# Autodesk Inventor assembly: Mockup
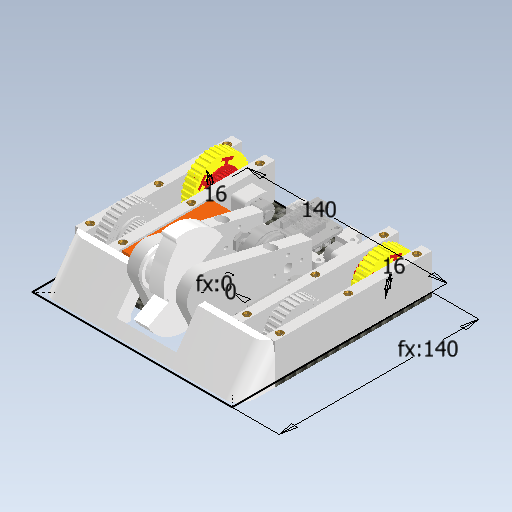
[picture p0: Inventor's stored thumbnail of the model, 512x512]
Saved by Autodesk Inventor 2026.4 (Build 304435030, 435C)
## iProperties
Created: 2026-11-08
Part Number: Mockup
Document SubType Name: Assembly
Designer: weira
Mass: 573.59 g
Surface Area: 731.437 cm^2
Volume: 125.835 cm^3
Density: 4.55828 g/cm^3
Author: weira
## Documents named in this file (10)
- C:\Users\weira\OneDrive\Desktop\Battlebot Projekt\Battle-Bot-Project\Inventor\Mockup.iam
- C:\Users\weira\OneDrive\Desktop\Battlebot Projekt\Battle-Bot-Project\Inventor\Kaufteile\MT2204_Brushless_Motor\MT2204_Brushless_Motor.ipt
- C:\Users\weira\OneDrive\Desktop\Battlebot Projekt\Battle-Bot-Project\Inventor\Fahrseite\Antrieb_links.iam
- C:\Users\weira\OneDrive\Desktop\Battlebot Projekt\Battle-Bot-Project\Inventor\Kaufteile\Tattu 2S 550mAh.ipt
- C:\Users\weira\OneDrive\Desktop\Battlebot Projekt\Battle-Bot-Project\Inventor\Kaufteile\Cyber_Brick_Receiver\Cyber_Brick_Receiver.ipt
- C:\Users\weira\OneDrive\Desktop\Battlebot Projekt\Battle-Bot-Project\Inventor\Kaufteile\Hobbywing_10A_ESC\Hobbywing_10A_ESC.ipt
- C:\Users\weira\OneDrive\Desktop\Battlebot Projekt\Battle-Bot-Project\Inventor\Bodenplatte.ipt
- C:\Users\weira\OneDrive\Desktop\Battlebot Projekt\Battle-Bot-Project\Inventor\Weaponassembly\Waffenhalterung_links.ipt
- C:\Users\weira\OneDrive\Desktop\Battlebot Projekt\Battle-Bot-Project\Inventor\Frontschild.ipt
- C:\Users\weira\OneDrive\Desktop\Battlebot Projekt\Battle-Bot-Project\Inventor\3D-Druckdaten\Waffendesign_infilloprimierer.ipt
## Components (11 placed, 9 different names)
1. Antrieb_links:1 [sub-assembly] — Passend:1, Fluchtend:1, Passend:2, Fluchtend:2, Passend:3, Fluchtend:5
2. Antrieb_links:2 [sub-assembly] — Fluchtend:2, Passend:3, Passend:4, Passend:5, Fluchtend:3, Fluchtend:4, Passend:13, Passend:24, Fluchtend:9
3. Bodenplatte:1 — Passend:5, Fluchtend:3, Fluchtend:4, Passend:12, Fluchtend:8
4. Tattu 2S 550mAh:1
5. Hobbywing_10A_ESC:1
6. Cyber_Brick_Receiver:1 — Passend:22, Passend:23, Fluchtend:7
7. Waffenhalterung_links:1 — Passend:7, Passend:9, Fluchtend:6, Passend:13, Passend:15, Passend:16, Passend:17, Passend:20, Passend:23
8. Waffenhalterung_links:2 — Passend:7, Passend:9, Passend:12, Fluchtend:6, Passend:22, Fluchtend:7, Passend:25, Passend:26, Passend:27
9. MT2204_Brushless_Motor:1 — Passend:15, Passend:16, Passend:17, Passend:20
10. Frontschild:1 — Fluchtend:8, Passend:24, Fluchtend:9, Passend:27
11. Waffendesign_infilloprimierer:1 — Passend:25, Passend:26
## Relationships (28: Mate 19, Flush 9)
- Passend:1 [Mate] (-70 mm): Antrieb_links:1
- Fluchtend:1 [Flush] (70 mm): Antrieb_links:1
- Passend:2 [Mate]: Antrieb_links:1
- Fluchtend:2 [Flush]: Antrieb_links:1 ↔ Antrieb_links:2
- Passend:3 [Mate] (-140 mm): Antrieb_links:1 ↔ Antrieb_links:2
- Passend:4 [Mate]: Antrieb_links:2
- Passend:5 [Mate]: Antrieb_links:2 ↔ Bodenplatte:1
- Fluchtend:3 [Flush]: Antrieb_links:2 ↔ Bodenplatte:1
- Fluchtend:4 [Flush]: Antrieb_links:2 ↔ Bodenplatte:1
- Fluchtend:5 [Flush]: Antrieb_links:1
- Passend:7 [Mate]: Waffenhalterung_links:1 ↔ Waffenhalterung_links:2
- Passend:9 [Mate] (26 mm): Waffenhalterung_links:1 ↔ Waffenhalterung_links:2
- Passend:12 [Mate]: Bodenplatte:1 ↔ Waffenhalterung_links:2
- Fluchtend:6 [Flush]: Waffenhalterung_links:1 ↔ Waffenhalterung_links:2
- Passend:13 [Mate]: Antrieb_links:2 ↔ Waffenhalterung_links:1
- Passend:15 [Mate]: Waffenhalterung_links:1 ↔ MT2204_Brushless_Motor:1
- Passend:16 [Mate]: Waffenhalterung_links:1 ↔ MT2204_Brushless_Motor:1
- Passend:17 [Mate]: Waffenhalterung_links:1 ↔ MT2204_Brushless_Motor:1
- Passend:20 [Mate]: Waffenhalterung_links:1 ↔ MT2204_Brushless_Motor:1
- Passend:22 [Mate]: Cyber_Brick_Receiver:1 ↔ Waffenhalterung_links:2
- Passend:23 [Mate]: Cyber_Brick_Receiver:1 ↔ Waffenhalterung_links:1
- Fluchtend:7 [Flush] (6.5 mm): Cyber_Brick_Receiver:1 ↔ Waffenhalterung_links:2
- Fluchtend:8 [Flush]: Bodenplatte:1 ↔ Frontschild:1
- Passend:24 [Mate]: Antrieb_links:2 ↔ Frontschild:1
- Fluchtend:9 [Flush]: Antrieb_links:2 ↔ Frontschild:1
- Passend:25 [Mate]: Waffenhalterung_links:2 ↔ Waffendesign_infilloprimierer:1
- Passend:26 [Mate]: Waffenhalterung_links:2 ↔ Waffendesign_infilloprimierer:1
- Passend:27 [Mate]: Waffenhalterung_links:2 ↔ Frontschild:1
